# Autodesk Inventor assembly: Rod
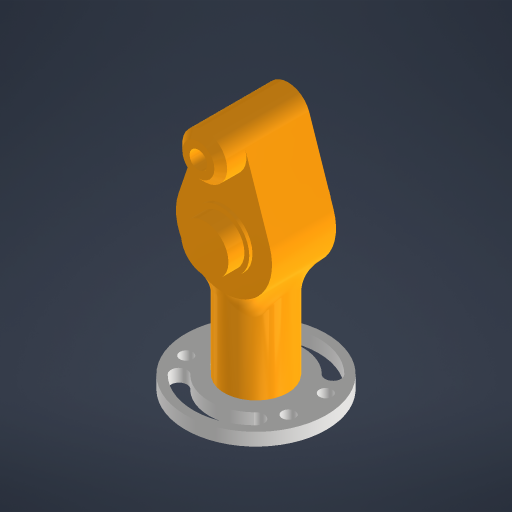
[picture p0: Inventor's stored thumbnail of the model, 512x512]
Saved by Autodesk Inventor 2023 (Build 270158000, 158)
## iProperties
Created: 2026-11-17
Part Number: Rod
Document SubType Name: Assembly
Designer: szykr
Author: szykr
## Documents named in this file (3)
- D:\Folder Instalacyjny\GitHub Pliki\HOTAS\Inventor\Gimbal\Rod.iam
- D:\Folder Instalacyjny\GitHub Pliki\HOTAS\Inventor\Gimbal\gimbal_lever_arm.ipt
- D:\Folder Instalacyjny\GitHub Pliki\HOTAS\Inventor\Gimbal\Adapter.ipt
## Components (2 placed, 2 different names)
1. gimbal_lever_arm:1 — Insert:1, Angle:1
2. Adapter:1 — Insert:1, Angle:1
## Relationships (2: Insert 1, Angle 1)
- Insert:1: gimbal_lever_arm:1 ↔ Adapter:1
- Angle:1 (-90 deg): gimbal_lever_arm:1 ↔ Adapter:1
